# Autodesk Inventor assembly: Medioreal.ipt
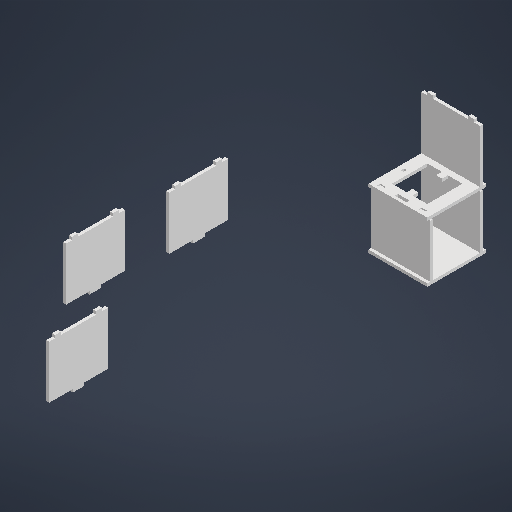
[picture p0: Inventor's stored thumbnail of the model, 512x512]
Saved by Autodesk Inventor 2025.2 (Build 292293000, 293)
## iProperties
Created: 2025-06-17
Part Number: Medioreal.ipt
Document SubType Name: Assembly
Designer: Niko
Author: Niko
## Documents named in this file (4)
- C:\Users\xxxx\OneDrive - Universidad San Sebastian\Escritorio\Elevator3000\Modelar\Medioreal.ipt.iam
- C:\Users\xxxx\OneDrive - Universidad San Sebastian\Escritorio\Elevator3000\Modelar\Medioreal.ipt
- C:\Users\xxxx\OneDrive - Universidad San Sebastian\Escritorio\Elevator3000\Modelar\Suelo.ipt
- C:\Users\xxxx\OneDrive - Universidad San Sebastian\Escritorio\Elevator3000\Modelar\Pared.ipt
## Components (8 placed, 3 different names)
1. Medioreal:1 — Rígido:3, Rígido:4
2. Suelo:1 — Rígido:1, Rígido:2
3. Pared:1 — Rígido:1, Rígido:3
4. Pared:2
5. Pared:3 — Rígido:2
6. Pared:4
7. Pared:5
8. Pared:6 — Rígido:4
## Relationships (4: WeldJoint 4)
- Rígido:1 [WeldJoint]: Suelo:1 ↔ Pared:1
- Rígido:2 [WeldJoint]: Suelo:1 ↔ Pared:3
- Rígido:3 [WeldJoint]: Medioreal:1 ↔ Pared:1
- Rígido:4 [WeldJoint]: Medioreal:1 ↔ Pared:6
